# Autodesk Inventor assembly: Assemblypale
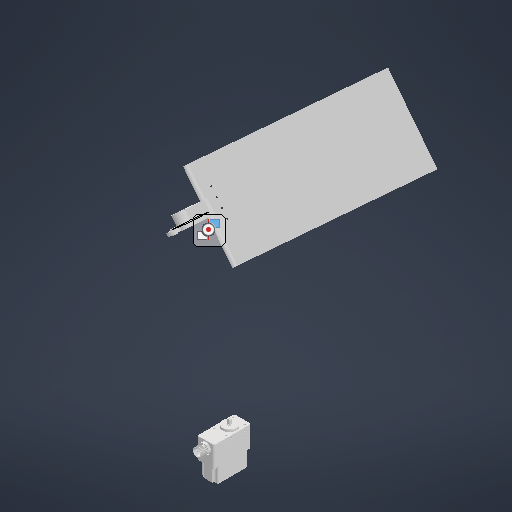
[picture p0: Inventor's stored thumbnail of the model, 512x512]
Saved by Autodesk Inventor 2026.1 (Build 301233000, 233)
## iProperties
Created: 2026-10-28
Part Number: Assemblypale
Document SubType Name: Assembly
Designer: elodi
Author: elodi
## Documents named in this file (6)
- C:\Users\elodi\Documents\Ingenieurie Systeme\Assemblypale.iam
- C:\Users\elodi\Documents\Ingenieurie Systeme\lien_servo_pale.ipt
- C:\Users\elodi\Documents\support_pale.ipt
- C:\Users\elodi\Documents\Ingenieurie Systeme\pale.ipt
- C:\Users\elodi\Downloads\D955TW-1642815574\SER-20XX Servo\SER-20XX Servo.ipt
- C:\Users\elodi\Downloads\D955TW-1642815574\SER-0010 Titanium Servo Hub\SER-0010 Titanium Servo Hub.ipt
## Components (5 placed, 5 different names)
1. lien_servo_pale:1 — Mate:1, Mate:2, Mate:3, Mate:7, Mate:8
2. support_pale:1 — Mate:1, Mate:2, Mate:3, Mate:4, Mate:5, Mate:6
3. pale:1 — Mate:4, Mate:5, Mate:6
4. SER-20XX Servo:1
5. SER-0010 Titanium Servo Hub:1 — Mate:7, Mate:8
## Relationships (8: Mate 8)
- Mate:1: lien_servo_pale:1 ↔ support_pale:1
- Mate:2: lien_servo_pale:1 ↔ support_pale:1
- Mate:3: lien_servo_pale:1 ↔ support_pale:1
- Mate:4: support_pale:1 ↔ pale:1
- Mate:5: support_pale:1 ↔ pale:1
- Mate:6: support_pale:1 ↔ pale:1
- Mate:7: lien_servo_pale:1 ↔ SER-0010 Titanium Servo Hub:1
- Mate:8: lien_servo_pale:1 ↔ SER-0010 Titanium Servo Hub:1
